# Autodesk Inventor assembly: STM32MiniF401
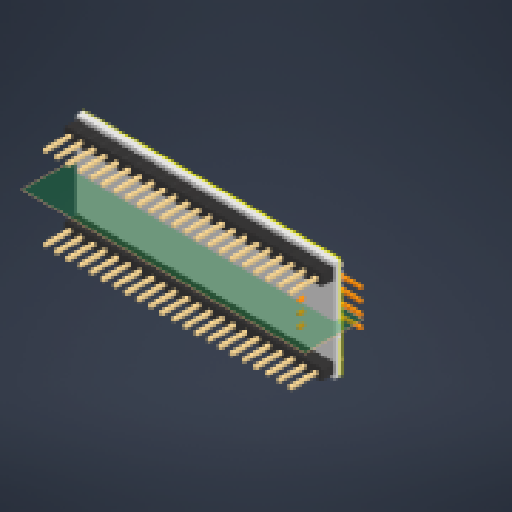
[picture p0: Inventor's stored thumbnail of the model, 512x512]
Saved by Autodesk Inventor 2027.1 (Build 311270010, 270A)
## iProperties
Created: 2024-04-23
Part Number: STM32MiniF401
Document SubType Name: Assembly
Designer: - LENOVO -
Sending System: Autodesk Inventor 2022
Preprocessor: ST-DEVELOPER v18.1
Title: C:\Users\- LENOVO -\OneDrive\Desktop\STM32 Mini F401\Assembly1.stp
Author: - LENOVO -
## Documents named in this file (16)
- C:\Users\lucao\Desktop\RL-Rotary-Inverted-Double-Pendulum\CAD\STM32 Mini F401\STM32MiniF401.iam
- C:\Users\lucao\Desktop\RL-Rotary-Inverted-Double-Pendulum\CAD\STM32 Mini F401\MainBoard.ipt
- C:\Users\lucao\Desktop\RL-Rotary-Inverted-Double-Pendulum\CAD\STM32 Mini F401\Part3.ipt
- C:\Users\lucao\Desktop\RL-Rotary-Inverted-Double-Pendulum\CAD\STM32 Mini F401\Part4.ipt
- C:\Users\lucao\Desktop\RL-Rotary-Inverted-Double-Pendulum\CAD\STM32 Mini F401\SOT-23.ipt
- C:\Users\lucao\Desktop\RL-Rotary-Inverted-Double-Pendulum\CAD\STM32 Mini F401\SOT-23-5.ipt
- C:\Users\lucao\Desktop\RL-Rotary-Inverted-Double-Pendulum\CAD\STM32 Mini F401\LED_0603_1608Metric.ipt
- C:\Users\lucao\Desktop\RL-Rotary-Inverted-Double-Pendulum\CAD\STM32 Mini F401\R_0402_1005Metric.ipt
- C:\Users\lucao\Desktop\RL-Rotary-Inverted-Double-Pendulum\CAD\STM32 Mini F401\C_0603_1608Metric.ipt
- C:\Users\lucao\Desktop\RL-Rotary-Inverted-Double-Pendulum\CAD\STM32 Mini F401\C_0402_1005Metric.ipt
- C:\Users\lucao\Desktop\RL-Rotary-Inverted-Double-Pendulum\CAD\STM32 Mini F401\USB_C_Receptacle_GCT_USB4105-xx-A_16P_TopMnt_Horizontal.ipt
- C:\Users\lucao\Desktop\RL-Rotary-Inverted-Double-Pendulum\CAD\STM32 Mini F401\UFQFPN_48-7x7.ipt
- C:\Users\lucao\Desktop\RL-Rotary-Inverted-Double-Pendulum\CAD\STM32 Mini F401\SW_SPST_B3U-1000P.ipt
- C:\Users\lucao\Desktop\RL-Rotary-Inverted-Double-Pendulum\CAD\STM32 Mini F401\PinHeader_1x22_P2.54mm_Vertical.ipt
- C:\Users\lucao\Desktop\RL-Rotary-Inverted-Double-Pendulum\CAD\STM32 Mini F401\Part58.ipt
- C:\Users\lucao\Desktop\RL-Rotary-Inverted-Double-Pendulum\CAD\STM32 Mini F401\PinHeader_4X1_right  .ipt
## Components (38 placed, 15 different names)
1. MainBoard:1
2. Part3:1
3. Part4:1
4. SOT-23:1
5. SOT-23-5:1
6. LED_0603_1608Metric:1
7. LED_0603_1608Metric:2
8. R_0402_1005Metric:1
9. R_0402_1005Metric:2
10. R_0402_1005Metric:3
11. R_0402_1005Metric:4
12. R_0402_1005Metric:5
13. R_0402_1005Metric:6
14. R_0402_1005Metric:7
15. R_0402_1005Metric:8
16. R_0402_1005Metric:9
17. R_0402_1005Metric:10
18. C_0603_1608Metric:1
19. C_0402_1005Metric:1
20. C_0402_1005Metric:2
21. C_0402_1005Metric:3
22. C_0402_1005Metric:4
23. C_0402_1005Metric:5
24. C_0402_1005Metric:6
25. C_0402_1005Metric:7
26. C_0402_1005Metric:8
27. C_0402_1005Metric:9
28. C_0402_1005Metric:10
29. C_0402_1005Metric:11
30. C_0402_1005Metric:12
31. C_0402_1005Metric:13
32. USB_C_Receptacle_GCT_USB4105-xx-A_16P_TopMnt_Horizontal:1
33. UFQFPN_48-7x7:1
34. SW_SPST_B3U-1000P:1
35. PinHeader_1x22_P2.54mm_Vertical:1 — Symmetry:1
36. PinHeader_1x22_P2.54mm_Vertical:2 — Symmetry:1
37. Part58:1
38. PinHeader_4X1_right  :1
## Relationships (1: Symmetry 1)
- Symmetry:1: PinHeader_1x22_P2.54mm_Vertical:1 ↔ PinHeader_1x22_P2.54mm_Vertical:2
